# Autodesk Inventor assembly: MM0948AN130_G13_001
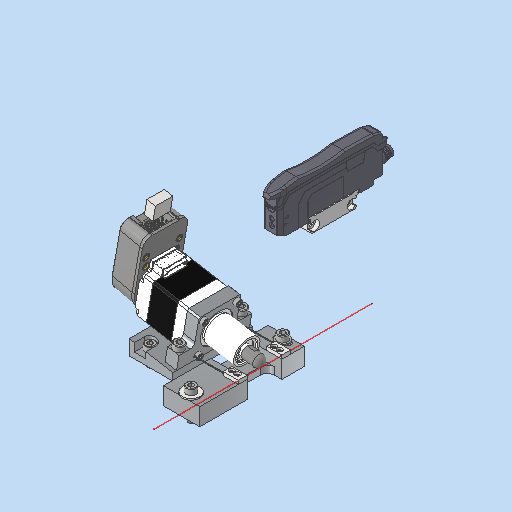
[picture p0: Inventor's stored thumbnail of the model, 512x512]
Saved by Autodesk Inventor 2023.3 (Build 273359000, 359)
## iProperties
Created: 2024-11-11
Part Number: MM0948AN130_G13_001
Description: =<RBPARTNOTITLE2>
Document SubType Name: Assembly
Designer: RIC7AN
Mass: 419.093 g
Surface Area: 548.731 cm^2
Volume: 104.972 cm^3
Density: 3.99243 g/cm^3
RBPARTMADEOF: --
RBDRAWINGMISSINGSPEC: --
AnP_Kategorie: 99
RBPARTNOTITLE2: Magazinentriegelung
RBSURFACE: --
RBPARTNOTITLE1: mask release actuator
AnP_Material: =<Material>
RBMATERIAL: =<Material>
RBMATNO: =<Part Number>
RBPARTNO: SIEHE MNR
Author: RIC7AN
Keywords: =<RBPARTMADEOF>
Comments: =<RBSURFACE2>
Revision Number: 01
## Documents named in this file (18)
- C:\Users\rea9an\Documents\Inventor\TCAI2412_te1910_EM\AS00000949.iam
- C:\Users\rea9an\Documents\Inventor\TCAI2412_te1910_EM\AS00000950.iam
- C:\Users\rea9an\Documents\Inventor\TCAI2412_te1910_EM\PT00004655.ipt
- C:\Users\rea9an\Documents\Inventor\TCAI2412_te1910_EM\PT00004657.ipt
- C:\Users\rea9an\Documents\Inventor\TCAI2412_te1910_EM\PT00004656.ipt
- C:\Users\rea9an\Documents\Inventor\TCAI2412_te1910_EM\PT00004868.ipt
- C:\Users\rea9an\Documents\Inventor\TCAI2412_te1910_EM\PT00004856.ipt
- C:\Users\rea9an\Documents\Inventor\TCAI2412_te1910_EM\PT00004866.ipt
- C:\Users\rea9an\Documents\Inventor\TCAI2412_te1910_EM\PT00004658.ipt
- C:\Users\rea9an\Documents\Inventor\TCAI2412_te1910_EM\AS00000905.iam
- C:\Users\rea9an\Documents\Inventor\TCAI2412_te1910_EM\PT00004783.ipt
- C:\Users\rea9an\Documents\Inventor\TCAI2412_te1910_EM\PT00004870.ipt
- C:\Users\rea9an\Documents\Inventor\TCAI2412_te1910_EM\PT00004778.ipt
- C:\Users\rea9an\Documents\Inventor\TCAI2412_te1910_EM\PT00004536.ipt
- C:\Users\rea9an\Documents\Inventor\TCAI2412_te1910_EM\PT00004535.ipt
- C:\Users\rea9an\Documents\Inventor\TCAI2412_te1910_EM\PT00004857.ipt
- C:\Users\rea9an\Documents\Inventor\TCAI2412_te1910_EM\PT00004720.ipt
- C:\Users\rea9an\Documents\Inventor\TCAI2412_te1910_EM\PT00004721.ipt
## Components (24 placed, 17 different names)
1. AS00000950:1 [sub-assembly] — Einfügen:3, Passend:4, Einfügen:19, Passend:22
2. PT00004655:1 — Passend:1, Fluchtend:1, Passend:3, Passend:4, Einfügen:4, Einfügen:5, Einfügen:6, Einfügen:7, Einfügen:8, Einfügen:9
3. PT00004656:1 — Passend:1, Fluchtend:1, Fluchtend:2, Passend:2, Fluchtend:3, Passend:3, Einfügen:10, Einfügen:11, Fluchtend:4, Fluchtend:5, Passend:7, Fluchtend:7, Passend:18, Passend:19
4. PT00004657:1 — Einfügen:3
5. PT00004868:1 — Einfügen:5
6. PT00004868:2 — Einfügen:4
7. PT00004856:1 — Einfügen:9
8. PT00004856:2 — Einfügen:8
9. PT00004856:3 — Einfügen:7
10. PT00004856:4 — Einfügen:6
11. PT00004866:1 — Einfügen:11
12. PT00004866:2 — Einfügen:10
13. PT00004658:1 — Einfügen:12, Einfügen:13, Passend:5, Passend:6, Fluchtend:4, Fluchtend:5, Passend:7, Passend:9, Passend:11, Passend:12, Passend:14, Passend:15
14. AS00000905:1 [sub-assembly] — Einfügen:12, Einfügen:13, Passend:5, Passend:6
15. PT00004783:1 — Passend:9, Passend:11, Einfügen:15
16. PT00004870:2 — Einfügen:15
17. PT00004870:3 — Passend:12, Passend:13
18. PT00004778:1 — Passend:14, Passend:15, Passend:13
19. PT00004536:1 — Fluchtend:7, Passend:18, Passend:19
20. PT00004535:1
21. PT00004857:1
22. PT00004857:2
23. PT00004720:1 — Fluchtend:8, Fluchtend:9, Passend:23
24. PT00004721:1 — Einfügen:19, Passend:22, Fluchtend:8, Fluchtend:9, Passend:23
## Relationships (44: Mate 19, Insert 16, Flush 9)
- [Insert]: AS00000950:1 ↔ PT00004655:1
- Einfügen:3 [Insert]: AS00000950:1 ↔ PT00004657:1
- Passend:1 [Mate]: PT00004655:1 ↔ PT00004656:1
- Fluchtend:1 [Flush]: PT00004655:1 ↔ PT00004656:1
- Fluchtend:2 [Flush]: PT00004656:1
- Passend:2 [Mate]: PT00004656:1
- Fluchtend:3 [Flush]: PT00004656:1
- Passend:3 [Mate]: PT00004655:1 ↔ PT00004656:1
- Passend:4 [Mate]: AS00000950:1 ↔ PT00004655:1
- Einfügen:4 [Insert]: PT00004655:1 ↔ PT00004868:2
- Einfügen:5 [Insert]: PT00004655:1 ↔ PT00004868:1
- Einfügen:6 [Insert]: PT00004655:1 ↔ PT00004856:4
- Einfügen:7 [Insert]: PT00004655:1 ↔ PT00004856:3
- Einfügen:8 [Insert]: PT00004655:1 ↔ PT00004856:2
- Einfügen:9 [Insert]: PT00004655:1 ↔ PT00004856:1
- Einfügen:10 [Insert]: PT00004656:1 ↔ PT00004866:2
- Einfügen:11 [Insert]: PT00004656:1 ↔ PT00004866:1
- Einfügen:12 [Insert]: PT00004658:1 ↔ AS00000905:1
- Einfügen:13 [Insert]: PT00004658:1 ↔ AS00000905:1
- Passend:5 [Mate]: PT00004658:1 ↔ AS00000905:1
- Passend:6 [Mate]: PT00004658:1 ↔ AS00000905:1
- Fluchtend:4 [Flush]: PT00004656:1 ↔ PT00004658:1
- Fluchtend:5 [Flush] (18 mm): PT00004656:1 ↔ PT00004658:1
- Passend:7 [Mate] (11.5 mm): PT00004656:1 ↔ PT00004658:1
- Passend:9 [Mate]: PT00004658:1 ↔ PT00004783:1
- Passend:11 [Mate]: PT00004658:1 ↔ PT00004783:1
- Einfügen:15 [Insert]: PT00004783:1 ↔ PT00004870:2
- Passend:12 [Mate]: PT00004658:1 ↔ PT00004870:3
- Passend:13 [Mate]: PT00004870:3 ↔ PT00004778:1
- Passend:14 [Mate]: PT00004658:1 ↔ PT00004778:1
- Passend:15 [Mate]: PT00004658:1 ↔ PT00004778:1
- [Mate]: PT00004536:1 ↔ PT00004535:1
- [Flush]: PT00004536:1 ↔ PT00004535:1
- [Mate]: PT00004536:1 ↔ PT00004535:1
- [Insert]: PT00004536:1 ↔ PT00004857:1
- [Insert]: PT00004536:1 ↔ PT00004857:2
- Fluchtend:7 [Flush] (10 mm): PT00004656:1 ↔ PT00004536:1
- Passend:18 [Mate]: PT00004656:1 ↔ PT00004536:1
- Passend:19 [Mate] (70 mm): PT00004656:1 ↔ PT00004536:1
- Einfügen:19 [Insert]: AS00000950:1 ↔ PT00004721:1
- Passend:22 [Mate]: AS00000950:1 ↔ PT00004721:1
- Fluchtend:8 [Flush]: PT00004720:1 ↔ PT00004721:1
- Fluchtend:9 [Flush]: PT00004720:1 ↔ PT00004721:1
- Passend:23 [Mate] (5 mm): PT00004720:1 ↔ PT00004721:1
